# Autodesk Inventor assembly: 部件1
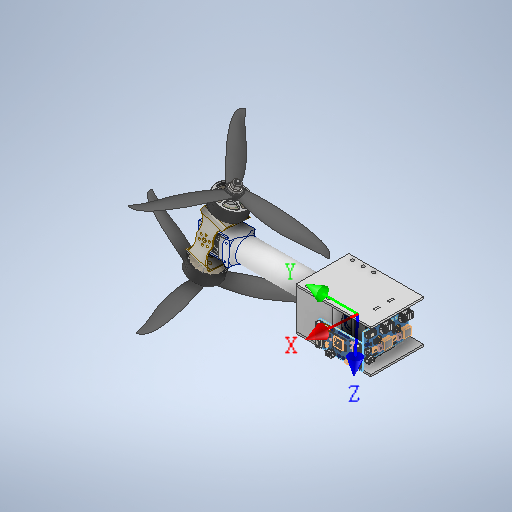
[picture p0: Inventor's stored thumbnail of the model, 512x512]
Saved by Autodesk Inventor 2025 (Build 290162000, 162)
## iProperties
Created: 2026-11-07
Part Number: 部件1
Document SubType Name: Assembly
Designer: ylh00
Mass: 328.98 g
Surface Area: 1416.05 cm^2
Volume: 149.871 cm^3
Density: 2.19509 g/cm^3
Author: ylh00
## Documents named in this file (14)
- D:\双轴共轴\部件1.iam
- D:\双轴共轴\支架.ipt
- D:\双轴共轴\舵机.ipt
- D:\双轴共轴\电机.ipt
- D:\双轴共轴\桨叶.ipt
- D:\双轴共轴\外端舵机支架.ipt
- D:\双轴共轴\轴承.ipt
- C:\Users\ylh00\Documents\Inventor\Content Center Files\R2025\zh-CN\GB_T 6187.1-2000\螺母 GB_T 6187.1 M5.ipt
- D:\双轴共轴\内端舵机支架1.ipt
- D:\双轴共轴\安装碳板1.ipt
- D:\双轴共轴\安装碳板2.ipt
- D:\双轴共轴\安装碳板3.ipt
- D:\双轴共轴\ecat控制板\ecat控制板.ipt
- D:\双轴共轴\ecat供电板\ecat供电板.ipt
## Components (18 placed, 13 different names)
1. 支架:1 — 旋转:14, 刚性:10, 刚性:11
2. 舵机:1 — 刚性:3, 旋转:14
3. 电机:1 — 旋转:4, 刚性:10
4. 电机:2 — 旋转:12, 刚性:11
5. 桨叶:1 — 旋转:4, 插入:1
6. 桨叶:2 — 旋转:12, 插入:2
7. 外端舵机支架:1 — 旋转:13, 刚性:3
8. 轴承:1
9. 轴承:2 — 旋转:13, 配合:1, 刚性:6
10. 螺母 GB/T 6187.1-2000 M5:1 — 插入:1
11. 螺母 GB/T 6187.1-2000 M5:2 — 插入:2
12. 舵机:2 — 配合:1, 刚性:9
13. 内端舵机支架1:1 — 刚性:6, 刚性:7, 刚性:8
14. 安装碳板1:1 — 刚性:7
15. 安装碳板2:1 — 刚性:8
16. 安装碳板3:1 — 刚性:9
17. ecat控制板:1
18. ecat供电板:1
## Relationships (14: WeldJoint 7, RevoluteJoint 4, Insert 2, Mate 1)
- 旋转:4 [RevoluteJoint]: 电机:1 ↔ 桨叶:1
- 插入:1 [Insert]: 桨叶:1 ↔ 螺母 GB/T 6187.1-2000 M5:1
- 旋转:12 [RevoluteJoint]: 电机:2 ↔ 桨叶:2
- 插入:2 [Insert]: 桨叶:2 ↔ 螺母 GB/T 6187.1-2000 M5:2
- 旋转:13 [RevoluteJoint]: 外端舵机支架:1 ↔ 轴承:2
- 刚性:3 [WeldJoint] (-0.1 mm): 舵机:1 ↔ 外端舵机支架:1
- 旋转:14 [RevoluteJoint]: 支架:1 ↔ 舵机:1
- 配合:1 [Mate]: 轴承:2 ↔ 舵机:2
- 刚性:6 [WeldJoint]: 轴承:2 ↔ 内端舵机支架1:1
- 刚性:7 [WeldJoint]: 内端舵机支架1:1 ↔ 安装碳板1:1
- 刚性:8 [WeldJoint]: 内端舵机支架1:1 ↔ 安装碳板2:1
- 刚性:9 [WeldJoint]: 舵机:2 ↔ 安装碳板3:1
- 刚性:10 [WeldJoint]: 支架:1 ↔ 电机:1
- 刚性:11 [WeldJoint]: 支架:1 ↔ 电机:2
